# Autodesk Inventor assembly: Montagem1
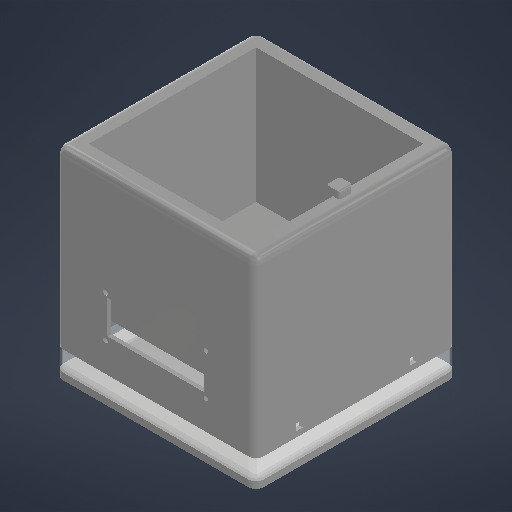
[picture p0: Inventor's stored thumbnail of the model, 512x512]
Saved by Autodesk Inventor 2027.1 (Build 311270010, 270A)
## iProperties
Created: 2026-07-28
Part Number: Montagem1
Document SubType Name: Assembly
Designer: enric
Author: enric
## Documents named in this file (4)
- C:\Users\enric\Documents\Inventor\Smart Planter\Montagem1.iam
- C:\Users\enric\Documents\Inventor\Smart Planter\Caixa Principal.ipt
- C:\Users\enric\Documents\Inventor\Smart Planter\Parte Plástica.ipt
- C:\Users\enric\Documents\Inventor\Smart Planter\Peça inferior.ipt
## Components (3 placed, 3 different names)
1. Caixa Principal:1 — Coincidente:1, Alinhado:1, Alinhado:2
2. Parte Plástica:1 — Coincidente:1, Alinhado:1, Alinhado:2, Coincidente:2, Alinhado:3, Alinhado:4
3. Peça inferior:1 — Coincidente:2, Alinhado:3, Alinhado:4
## Relationships (6: Flush 4, Mate 2)
- Coincidente:1 [Mate]: Caixa Principal:1 ↔ Parte Plástica:1
- Alinhado:1 [Flush]: Caixa Principal:1 ↔ Parte Plástica:1
- Alinhado:2 [Flush]: Caixa Principal:1 ↔ Parte Plástica:1
- Coincidente:2 [Mate]: Parte Plástica:1 ↔ Peça inferior:1
- Alinhado:3 [Flush]: Parte Plástica:1 ↔ Peça inferior:1
- Alinhado:4 [Flush]: Parte Plástica:1 ↔ Peça inferior:1
